# Autodesk Inventor assembly: MM0948AN110_G12_001
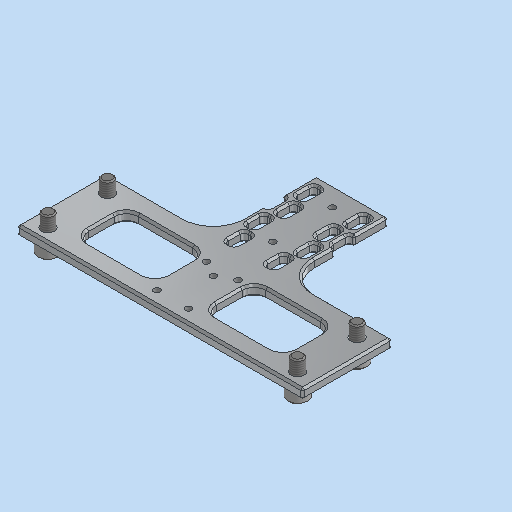
[picture p0: Inventor's stored thumbnail of the model, 512x512]
Saved by Autodesk Inventor 2023.3 (Build 273359000, 359)
## iProperties
Created: 2024-09-05
Part Number: MM0948AN110_G12_001
Description: =<RBPARTNOTITLE2>
Document SubType Name: Assembly
Designer: RIC7AN
Mass: 51.1472 g
Surface Area: 186.297 cm^2
Volume: 31.5227 cm^3
Density: 1.62255 g/cm^3
RBPARTMADEOF: --
RBDRAWINGMISSINGSPEC: --
AnP_Kategorie: 99
RBPARTNOTITLE2: Kabelhalter Z-Achse
RBSURFACE: --
RBPARTNOTITLE1: cable holder Z-axis
AnP_Material: =<Material>
RBMATERIAL: =<Material>
RBMATNO: =<Part Number>
RBPARTNO: SIEHE MNR
Author: RIC7AN
Keywords: =<RBPARTMADEOF>
Comments: =<RBSURFACE2>
Revision Number: 01
## Documents named in this file (3)
- C:\Users\rea9an\Documents\Inventor\TCAI2412_te1910_EM\AS00000944.iam
- C:\Users\rea9an\Documents\Inventor\TCAI2412_te1910_EM\PT00004631.ipt
- C:\Users\rea9an\Documents\Inventor\TCAI2412_te1910_EM\PT00004886.ipt
## Components (5 placed, 2 different names)
1. PT00004631:1
2. PT00004886:1
3. PT00004886:2
4. PT00004886:3
5. PT00004886:4
## Relationships (4: Insert 4)
- [Insert]: PT00004631:1 ↔ PT00004886:1
- [Insert]: PT00004631:1 ↔ PT00004886:2
- [Insert]: PT00004631:1 ↔ PT00004886:4
- [Insert]: PT00004631:1 ↔ PT00004886:3
